# Autodesk Inventor assembly: 2B_set
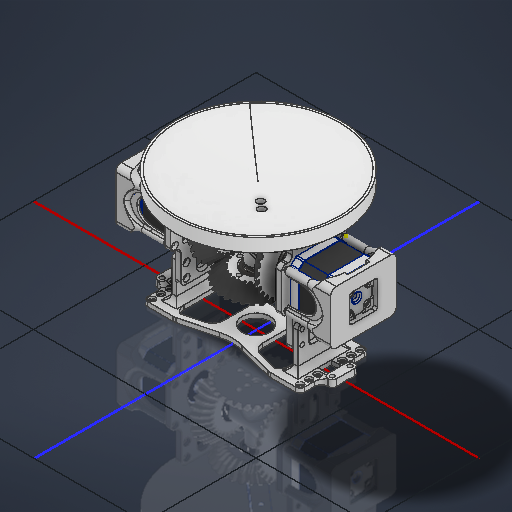
[picture p0: Inventor's stored thumbnail of the model, 512x512]
Saved by Autodesk Inventor 2026.2 (Build 302298010, 298A)
## iProperties
Created: 2026-03-18
Part Number: 2B_set
Document SubType Name: Assembly
Designer: work
Author: work
## Documents named in this file (18)
- C:\Users\work\Desktop\AC3\2B\2B_set.iam
- C:\Users\work\Desktop\AC3\2B\1\A.ipt
- C:\Users\work\Desktop\AC3\2B\C.ipt
- C:\Users\work\Desktop\AC3\2B\JIS B 1521 SKF (D) - SKF 608-Z.ipt
- C:\Users\work\Desktop\AC3\2B\5_Co.ipt
- C:\Users\work\Desktop\AC3\2B\NEMA17.ipt
- C:\Users\work\Desktop\AC3\2B\1\B.ipt
- C:\Users\work\Desktop\AC3\2B\R-1.ipt
- C:\Users\work\Desktop\AC3\2B\R-2.ipt
- C:\Users\work\Desktop\AC3\2B\로드셀 센서.ipt
- C:\Users\work\Desktop\AC3\2B\as5600_holder.ipt
- C:\Users\work\Desktop\AC3\2B\hol.ipt
- C:\Users\work\Desktop\AC3\2B\RALI1.ipt
- C:\Users\work\Desktop\AC3\2B\2B_set\AIP\FEA\fdflh83ds.fins
- C:\Users\work\Desktop\AC3\2B\2B_set\AIP\FEA\fdflh83ds.fsat
- C:\Users\work\Desktop\AC3\2B\2B_set\AIP\FEA\fdflh83ds.ftes
- C:\Users\work\Desktop\AC3\2B\2B_set\AIP\FEA\fdflh83ds.fwiz
- C:\Users\khw\Downloads\AC3\2B\2B_set\AIP\FEA\fdflh83kw.fmsh
## Components (21 placed, 12 different names)
1. JIS B 1521 SKF (D) - SKF 608-Z:4 — 메이트:50, 플러쉬:3
2. B:2 — 회전:3
3. as5600_holder:1 — 메이트:58, 메이트:59, 메이트:60
4. RALI1:1 — 메이트:61, 메이트:62, 메이트:63, 메이트:64, 메이트:65, 각도:8
5. hol:1 — 메이트:51, 각도:5, 메이트:52, 메이트:58, 메이트:59
6. hol:2 — 메이트:53, 메이트:54, 각도:7, 메이트:56, 메이트:57, 메이트:61, 메이트:62, 메이트:63
7. as5600_holder:2 — 메이트:55, 메이트:56, 메이트:57
8. R-2:1 — 메이트:34, 메이트:35, 메이트:36, 메이트:38, 메이트:39, 메이트:47
9. R-1:1 — 메이트:40, 메이트:41, 메이트:42
10. A:1 — 메이트:1, 메이트:2, 메이트:11, 메이트:19, 메이트:22, 메이트:23, 회전:1, 각도:1
11. C:1 — 메이트:7, 메이트:8, 메이트:9, 메이트:10, 메이트:11, 메이트:27, 각도:4, 메이트:50, 플러쉬:3
12. A:2 — 메이트:10, 메이트:20, 메이트:21, 메이트:24, 회전:2
13. 5_Co:4 — 메이트:22, 메이트:23, 메이트:54
14. 5_Co:3 — 메이트:15, 플러쉬:1, 메이트:21, 메이트:24, 회전:3
15. B:1 — 메이트:25, 메이트:26, 메이트:27, 회전:1, 회전:2, 메이트:34, 메이트:35, 메이트:36
16. JIS B 1521 SKF (D) - SKF 608-Z:2 — 메이트:8
17. JIS B 1521 SKF (D) - SKF 608-Z:3 — 메이트:7, 메이트:25, 메이트:26
18. JIS B 1521 SKF (D) - SKF 608-Z:1 — 메이트:1, 메이트:2, 메이트:9
19. NEMA17:1 — 메이트:15, 플러쉬:1, 메이트:20, 각도:4, 메이트:51, 각도:5, 각도:6, 메이트:52, 메이트:60
20. NEMA17:2 — 메이트:19, 각도:1, 각도:6, 메이트:53, 각도:7, 메이트:55
21. 로드셀 센서:1 — 메이트:38, 메이트:39, 메이트:40, 메이트:41, 메이트:42, 메이트:47
## Relationships (59: Mate 47, Angle 6, Flush 3, RelateRotation 3)
- 메이트:1 [Mate]: A:1 ↔ JIS B 1521 SKF (D) - SKF 608-Z:1
- 메이트:2 [Mate]: A:1 ↔ JIS B 1521 SKF (D) - SKF 608-Z:1
- [Mate]: A:2 ↔ JIS B 1521 SKF (D) - SKF 608-Z:2
- [Mate]: A:2 ↔ JIS B 1521 SKF (D) - SKF 608-Z:2
- 메이트:7 [Mate]: C:1 ↔ JIS B 1521 SKF (D) - SKF 608-Z:3
- 메이트:8 [Mate]: C:1 ↔ JIS B 1521 SKF (D) - SKF 608-Z:2
- 메이트:9 [Mate]: C:1 ↔ JIS B 1521 SKF (D) - SKF 608-Z:1
- 메이트:10 [Mate]: C:1 ↔ A:2
- 메이트:11 [Mate]: A:1 ↔ C:1
- 메이트:15 [Mate]: 5_Co:3 ↔ NEMA17:1
- 플러쉬:1 [Flush]: 5_Co:3 ↔ NEMA17:1
- [Mate]: 5_Co:4 ↔ NEMA17:2
- [Flush]: 5_Co:4 ↔ NEMA17:2
- 메이트:19 [Mate]: A:1 ↔ NEMA17:2
- 메이트:20 [Mate]: A:2 ↔ NEMA17:1
- 메이트:21 [Mate]: A:2 ↔ 5_Co:3
- 메이트:22 [Mate]: A:1 ↔ 5_Co:4
- 메이트:23 [Mate]: A:1 ↔ 5_Co:4
- 메이트:24 [Mate]: A:2 ↔ 5_Co:3
- 메이트:25 [Mate]: B:1 ↔ JIS B 1521 SKF (D) - SKF 608-Z:3
- 메이트:26 [Mate]: B:1 ↔ JIS B 1521 SKF (D) - SKF 608-Z:3
- 메이트:27 [Mate]: C:1 ↔ B:1
- 회전:1 [RelateRotation] (1 ul): A:1 ↔ B:1
- 회전:2 [RelateRotation] (1 ul): A:2 ↔ B:1
- 각도:1 [Angle] (720 deg): A:1 ↔ NEMA17:2
- 각도:4 [Angle] (180 deg): C:1 ↔ NEMA17:1
- 메이트:34 [Mate]: R-2:1 ↔ B:1
- 메이트:35 [Mate]: R-2:1 ↔ B:1
- 메이트:36 [Mate]: R-2:1 ↔ B:1
- 메이트:38 [Mate]: R-2:1 ↔ 로드셀 센서:1
- 메이트:39 [Mate]: R-2:1 ↔ 로드셀 센서:1
- 메이트:40 [Mate]: R-1:1 ↔ 로드셀 센서:1
- 메이트:41 [Mate]: R-1:1 ↔ 로드셀 센서:1
- 메이트:42 [Mate]: R-1:1 ↔ 로드셀 센서:1
- 메이트:47 [Mate]: R-2:1 ↔ 로드셀 센서:1
- [Mate]: JIS B 1521 SKF (D) - SKF 608-Z:4 ↔ B:2
- [Mate]: JIS B 1521 SKF (D) - SKF 608-Z:4 ↔ B:2
- 메이트:50 [Mate]: JIS B 1521 SKF (D) - SKF 608-Z:4 ↔ C:1
- 플러쉬:3 [Flush]: JIS B 1521 SKF (D) - SKF 608-Z:4 ↔ C:1
- 회전:3 [RelateRotation] (1 ul): B:2 ↔ 5_Co:3
- 메이트:51 [Mate]: hol:1 ↔ NEMA17:1
- 각도:5 [Angle] (0 deg): hol:1 ↔ NEMA17:1
- 각도:6 [Angle] (0 deg): NEMA17:1 ↔ NEMA17:2
- 메이트:52 [Mate]: hol:1 ↔ NEMA17:1
- 메이트:53 [Mate]: hol:2 ↔ NEMA17:2
- 메이트:54 [Mate]: hol:2 ↔ 5_Co:4
- 각도:7 [Angle] (0 deg): hol:2 ↔ NEMA17:2
- 메이트:55 [Mate] (1 mm): as5600_holder:2 ↔ NEMA17:2
- 메이트:56 [Mate]: hol:2 ↔ as5600_holder:2
- 메이트:57 [Mate]: hol:2 ↔ as5600_holder:2
- 메이트:58 [Mate]: as5600_holder:1 ↔ hol:1
- 메이트:59 [Mate]: as5600_holder:1 ↔ hol:1
- 메이트:60 [Mate] (1 mm): as5600_holder:1 ↔ NEMA17:1
- 메이트:61 [Mate]: RALI1:1 ↔ hol:2
- 메이트:62 [Mate]: RALI1:1 ↔ hol:2
- 메이트:63 [Mate]: RALI1:1 ↔ hol:2
- 메이트:64 [Mate]: RALI1:1
- 메이트:65 [Mate]: RALI1:1
- 각도:8 [Angle] (0 deg): RALI1:1
## Named parameters: d3_d1 = 0 mm, d4_d2 = 0 mm, d19_d15 = 0 mm, d20_d16 = 0 mm, sa_0 = 10000, d161_d108 = 0 mm, d162_d109 = 0 mm
note: some values were not read from the file. Shown as the stored number, unit unknown: "sa_0".
